# Autodesk Inventor assembly: ass
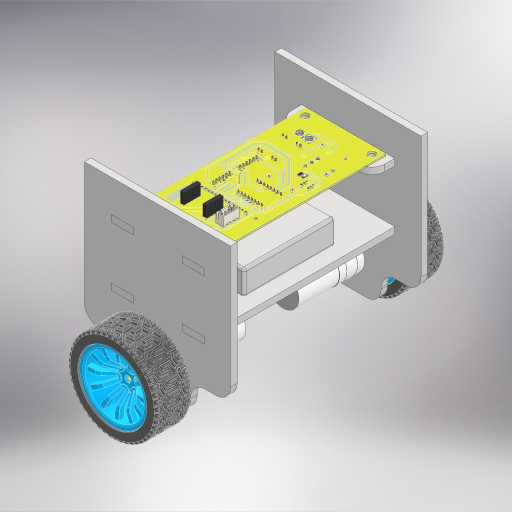
[picture p0: Inventor's stored thumbnail of the model, 512x512]
Saved by Autodesk Inventor 2023.5 (Build 275446000, 446)
## iProperties
Created: 2026-10-31
Part Number: ass
Document SubType Name: Assembly
Designer: WORKPLUS
Author: WORKPLUS
## Documents named in this file (8)
- C:\Penyimpanan Utama\Documents\5. Semester 5\PSKL\TWABR\ass.iam
- C:\Penyimpanan Utama\Documents\5. Semester 5\PSKL\TWABR\board_holder.ipt
- C:\Penyimpanan Utama\Documents\5. Semester 5\PSKL\TWABR\side.ipt
- C:\Penyimpanan Utama\Documents\5. Semester 5\PSKL\TWABR\batt_holder.ipt
- C:\Penyimpanan Utama\Documents\5. Semester 5\PSKL\TWABR\dummy_batt.ipt
- C:\Penyimpanan Utama\Documents\5. Semester 5\PSKL\TWABR\dc-motor-jga25-370-geared-motor-25mm-1.snapshot.1\01_JGA25-370_Geared_Motor\01_JGA25-370_Motor_Full_Assembly\01_JGA25-370_Motor_Full_Assembly.iam
- C:\Penyimpanan Utama\Documents\5. Semester 5\PSKL\TWABR\copper-coupling-metal-wheel-yellow-dc-motor-1.snapshot.3\65mm蓝色轮胎总装-实际外径68mm\65mm蓝色轮胎总装-实际外径68mm.iam
- C:\Penyimpanan Utama\Documents\5. Semester 5\PSKL\TWABR\PSKL_board_v1\PSKL_board_v1.iam
## Components (11 placed, 7 different names)
1. board_holder:1 — Mate:7, Flush:4, Mate:13, Mate:28, Mate:29, Mate:31
2. board_holder:2 — Mate:9, Mate:10, Flush:5, Mate:30
3. side:1 — Mate:7, Flush:3, Mate:11, Mate:12, Flush:4, Mate:13, Mate:15, Mate:21, Mate:22, Mate:23, Mate:25
4. side:2 — Mate:9, Mate:10, Flush:5, Mate:17, Mate:19, Mate:20, Mate:27
5. batt_holder:1 — Flush:3, Mate:11, Mate:12, Flush:6, Mate:18
6. dummy_batt:1 — Mate:15, Flush:6, Mate:18
7. 01_JGA25-370_Motor_Full_Assembly:1 [sub-assembly] — Mate:17, Mate:19, Mate:20, Mate:26
8. 01_JGA25-370_Motor_Full_Assembly:2 [sub-assembly] — Mate:21, Mate:22, Mate:23, Mate:24
9. 65mm蓝色轮胎总装-实际外径68mm:1 [sub-assembly] — Mate:24, Mate:25
10. 65mm蓝色轮胎总装-实际外径68mm:2 [sub-assembly] — Mate:26, Mate:27
11. PSKL_board_v1:1 [sub-assembly] — Mate:28, Mate:29, Mate:30, Mate:31
## Relationships (26: Mate 22, Flush 4)
- Mate:7: board_holder:1 ↔ side:1
- Mate:9: board_holder:2 ↔ side:2
- Mate:10: board_holder:2 ↔ side:2
- Flush:3: side:1 ↔ batt_holder:1
- Mate:11: side:1 ↔ batt_holder:1
- Mate:12: side:1 ↔ batt_holder:1
- Flush:4: board_holder:1 ↔ side:1
- Mate:13: board_holder:1 ↔ side:1
- Flush:5: board_holder:2 ↔ side:2
- Mate:15 (35 mm): side:1 ↔ dummy_batt:1
- Flush:6 (10 mm): batt_holder:1 ↔ dummy_batt:1
- Mate:17: side:2 ↔ 01_JGA25-370_Motor_Full_Assembly:1
- Mate:18: batt_holder:1 ↔ dummy_batt:1
- Mate:19: side:2 ↔ 01_JGA25-370_Motor_Full_Assembly:1
- Mate:20: side:2 ↔ 01_JGA25-370_Motor_Full_Assembly:1
- Mate:21: side:1 ↔ 01_JGA25-370_Motor_Full_Assembly:2
- Mate:22: side:1 ↔ 01_JGA25-370_Motor_Full_Assembly:2
- Mate:23: side:1 ↔ 01_JGA25-370_Motor_Full_Assembly:2
- Mate:24: 01_JGA25-370_Motor_Full_Assembly:2 ↔ 65mm蓝色轮胎总装-实际外径68mm:1
- Mate:25 (3 mm): side:1 ↔ 65mm蓝色轮胎总装-实际外径68mm:1
- Mate:26: 01_JGA25-370_Motor_Full_Assembly:1 ↔ 65mm蓝色轮胎总装-实际外径68mm:2
- Mate:27 (3 mm): side:2 ↔ 65mm蓝色轮胎总装-实际外径68mm:2
- Mate:28: board_holder:1 ↔ PSKL_board_v1:1
- Mate:29: board_holder:1 ↔ PSKL_board_v1:1
- Mate:30: board_holder:2 ↔ PSKL_board_v1:1
- Mate:31: board_holder:1 ↔ PSKL_board_v1:1
